# Autodesk Inventor assembly: ASY DMF-1200 Gear Cap
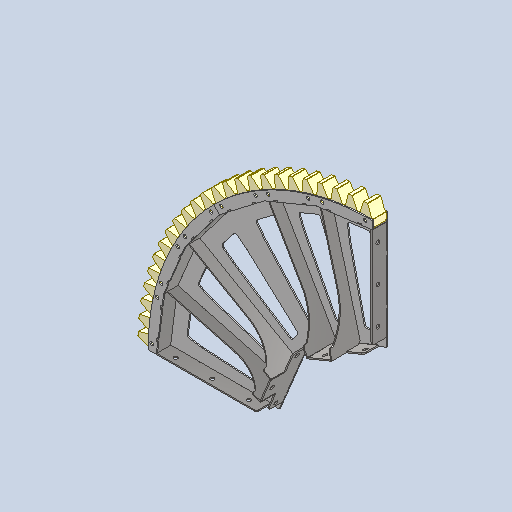
[picture p0: Inventor's stored thumbnail of the model, 512x512]
Saved by Autodesk Inventor 2026.2 (Build 302298000, 298)
## iProperties
Created: 2024-04-30
Part Number: ASY DMF-1200 Gear Cap
Document SubType Name: Assembly
Designer: admin
Stock Number: DMF-1200
Author: admin
## Documents named in this file (8)
- C:\Users\admin\Documents\Inventor\DMF-Disk-Micro-Filter\Барабан v2.1\ASY DMF-1200 Gear Cap.iam
- C:\Users\admin\Documents\Inventor\DMF-Disk-Micro-Filter\Барабан v2.1\DMF-1203 Big Sector.ipt
- C:\Users\admin\Documents\Inventor\DMF-Disk-Micro-Filter\шестерни 06.09.2025\DMF-1201 Big Gear Sector.ipt
- C:\Users\admin\Documents\Inventor\DMF-Disk-Micro-Filter\Барабан v2.1\DMF-1206 Slot Plate Large 01.ipt
- C:\Users\admin\Documents\Inventor\DMF-Disk-Micro-Filter\Барабан v2.1\DMF-1209 Gear Rim 02.ipt
- C:\Users\admin\Documents\Inventor\DMF-Disk-Micro-Filter\Барабан v2.1\Хорды 0144\DMF-1208 Chord.ipt
- C:\Users\admin\Documents\Inventor\DMF-Disk-Micro-Filter\Барабан v2.1\DMF-1215 base Plate.ipt
- C:\Users\admin\Documents\Inventor\DMF-Disk-Micro-Filter\Барабан v2.1\DMF-1214 Slot spoke 1.ipt
## Components (23 placed, 7 different names)
1. DMF-1203 Big Sector:1 — Mate:1, Mate:2, Mate:4, Mate:5, Mate:7, Mate:8, Mate:10, Mate:11, Mate:13, Mate:14, Mate:16, Mate:17, Mate:22, Mate:33, Mate:38, Mate:42, Rigid:1, Rigid:3
2. DMF-1201 Big Gear Sector:1
3. DMF-1201 Big Gear Sector:2
4. DMF-1201 Big Gear Sector:3
5. DMF-1201 Big Gear Sector:4
6. DMF-1201 Big Gear Sector:5
7. DMF-1201 Big Gear Sector:6
8. DMF-1206 Slot Plate Large 01:1 — Mate:38, Mate:39, Mate:48, Mate:50
9. DMF-1206 Slot Plate Large 01:2 — Mate:33, Mate:34, Mate:49, Mate:51
10. DMF-1208 Chord:1 — Mate:1, Mate:2, Mate:3, Flush:2, Rigid:6
11. DMF-1208 Chord:2 — Mate:3, Mate:4, Mate:5, Mate:6, Mate:39, Mate:50
12. DMF-1208 Chord:3 — Mate:6, Mate:7, Mate:8, Mate:9, Mate:34, Mate:51
13. DMF-1208 Chord:4 — Mate:9, Mate:10, Mate:11, Mate:12, Flush:4
14. DMF-1208 Chord:5 — Mate:12, Mate:13, Mate:14, Mate:15, Mate:43, Mate:45
15. DMF-1208 Chord:6 — Mate:15, Mate:16, Mate:17, Mate:20, Mate:21, Mate:47, Rigid:7
16. DMF-1209 Gear Rim 02:1 — Flush:2, Rigid:6
17. DMF-1209 Gear Rim 02:2 — Mate:20, Flush:4, Rigid:7
18. DMF-1206 Slot Plate Large 01:3 — Mate:42, Mate:43, Mate:44, Mate:45
19. DMF-1206 Slot Plate Large 01:4 — Mate:21, Mate:22, Mate:46, Mate:47
20. DMF-1215 base Plate:1 — Rigid:3, Mate:44, Mate:46
21. DMF-1215 base Plate:2 — Rigid:1, Mate:48, Mate:49
22. DMF-1214 Slot spoke 1:1
23. DMF-1214 Slot spoke 1:2
## Relationships (40: Mate 34, WeldJoint 4, Flush 2)
- Mate:1: DMF-1203 Big Sector:1 ↔ DMF-1208 Chord:1
- Mate:2: DMF-1203 Big Sector:1 ↔ DMF-1208 Chord:1
- Mate:3: DMF-1208 Chord:1 ↔ DMF-1208 Chord:2
- Mate:4: DMF-1203 Big Sector:1 ↔ DMF-1208 Chord:2
- Mate:5: DMF-1203 Big Sector:1 ↔ DMF-1208 Chord:2
- Mate:6: DMF-1208 Chord:2 ↔ DMF-1208 Chord:3
- Mate:7: DMF-1203 Big Sector:1 ↔ DMF-1208 Chord:3
- Mate:8: DMF-1203 Big Sector:1 ↔ DMF-1208 Chord:3
- Mate:9: DMF-1208 Chord:3 ↔ DMF-1208 Chord:4
- Mate:10: DMF-1203 Big Sector:1 ↔ DMF-1208 Chord:4
- Mate:11: DMF-1203 Big Sector:1 ↔ DMF-1208 Chord:4
- Mate:12: DMF-1208 Chord:4 ↔ DMF-1208 Chord:5
- Mate:13: DMF-1203 Big Sector:1 ↔ DMF-1208 Chord:5
- Mate:14: DMF-1203 Big Sector:1 ↔ DMF-1208 Chord:5
- Mate:15: DMF-1208 Chord:5 ↔ DMF-1208 Chord:6
- Mate:16: DMF-1203 Big Sector:1 ↔ DMF-1208 Chord:6
- Mate:17: DMF-1203 Big Sector:1 ↔ DMF-1208 Chord:6
- Flush:2: DMF-1208 Chord:1 ↔ DMF-1209 Gear Rim 02:1
- Mate:20: DMF-1208 Chord:6 ↔ DMF-1209 Gear Rim 02:2
- Flush:4: DMF-1208 Chord:4 ↔ DMF-1209 Gear Rim 02:2
- Mate:21: DMF-1208 Chord:6 ↔ DMF-1206 Slot Plate Large 01:4
- Mate:22: DMF-1203 Big Sector:1 ↔ DMF-1206 Slot Plate Large 01:4
- Mate:33: DMF-1203 Big Sector:1 ↔ DMF-1206 Slot Plate Large 01:2
- Mate:34: DMF-1206 Slot Plate Large 01:2 ↔ DMF-1208 Chord:3
- Mate:38: DMF-1203 Big Sector:1 ↔ DMF-1206 Slot Plate Large 01:1
- Mate:39: DMF-1206 Slot Plate Large 01:1 ↔ DMF-1208 Chord:2
- Mate:42: DMF-1203 Big Sector:1 ↔ DMF-1206 Slot Plate Large 01:3
- Mate:43: DMF-1208 Chord:5 ↔ DMF-1206 Slot Plate Large 01:3
- Rigid:1 [WeldJoint]: DMF-1203 Big Sector:1 ↔ DMF-1215 base Plate:2
- Rigid:3 [WeldJoint]: DMF-1203 Big Sector:1 ↔ DMF-1215 base Plate:1
- Mate:44: DMF-1206 Slot Plate Large 01:3 ↔ DMF-1215 base Plate:1
- Mate:45: DMF-1208 Chord:5 ↔ DMF-1206 Slot Plate Large 01:3
- Mate:46: DMF-1206 Slot Plate Large 01:4 ↔ DMF-1215 base Plate:1
- Mate:47: DMF-1208 Chord:6 ↔ DMF-1206 Slot Plate Large 01:4
- Rigid:6 [WeldJoint]: DMF-1208 Chord:1 ↔ DMF-1209 Gear Rim 02:1
- Rigid:7 [WeldJoint]: DMF-1208 Chord:6 ↔ DMF-1209 Gear Rim 02:2
- Mate:48: DMF-1206 Slot Plate Large 01:1 ↔ DMF-1215 base Plate:2
- Mate:49: DMF-1206 Slot Plate Large 01:2 ↔ DMF-1215 base Plate:2
- Mate:50: DMF-1206 Slot Plate Large 01:1 ↔ DMF-1208 Chord:2
- Mate:51: DMF-1206 Slot Plate Large 01:2 ↔ DMF-1208 Chord:3
